# Autodesk Inventor assembly: ICF-70-nipple-VUV
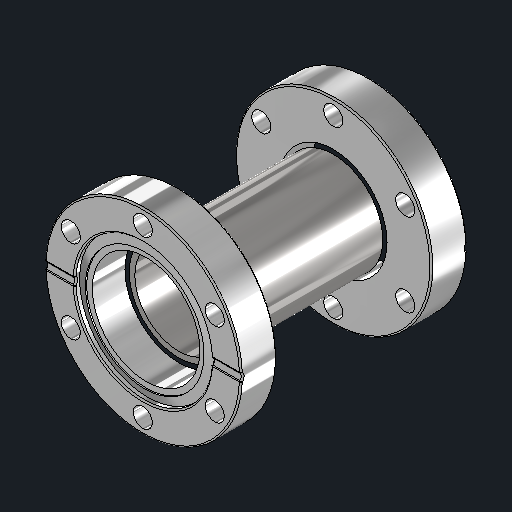
[picture p0: Inventor's stored thumbnail of the model, 512x512]
Saved by Autodesk Inventor 2027.1 (Build 311270010, 270A)
## iProperties
Created: 2019-08-29
Part Number: ICF-70-nipple-VUV
Document SubType Name: Assembly
Designer: kuzmin
Mass: 674.312 g
Surface Area: 356.855 cm^2
Volume: 84.289 cm^3
Density: 8 g/cm^3
Author: kuzmin
## Documents named in this file (3)
- C:\Users\queezz\Dropbox\Drawings\pihti-cad\Miura-membrane-experiments\components\ICF-70-nipple-VUV.iam
- C:\Users\queezz\Dropbox\Drawings\pihti-cad\Miura-membrane-experiments\components\cf70_two-feeds.ipt
- C:\Users\queezz\Dropbox\Drawings\pihti-cad\Miura-membrane-experiments\components\ICF-70-nipple-VUV.ipt
## Components (3 placed, 2 different names)
1. cf70_two-feeds:1 — Mate:1, Mate:4, Mate:5
2. cf70_two-feeds:2 — Mate:2, Mate:3, Mate:5
3. ICF-70-nipple-VUV:1 — Mate:1, Mate:2, Mate:3, Mate:4
## Relationships (5: Mate 5)
- Mate:1: cf70_two-feeds:1 ↔ ICF-70-nipple-VUV:1
- Mate:2: cf70_two-feeds:2 ↔ ICF-70-nipple-VUV:1
- Mate:3: cf70_two-feeds:2 ↔ ICF-70-nipple-VUV:1
- Mate:4: cf70_two-feeds:1 ↔ ICF-70-nipple-VUV:1
- Mate:5 (-80 mm): cf70_two-feeds:1 ↔ cf70_two-feeds:2
